# Autodesk Inventor assembly: Assembly1_stp
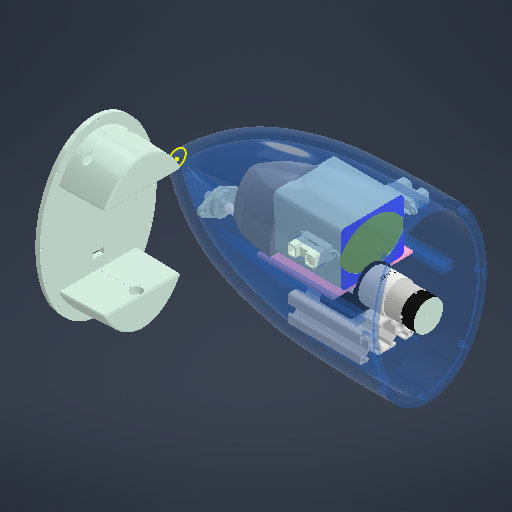
[picture p0: Inventor's stored thumbnail of the model, 512x512]
Saved by Autodesk Inventor 2027 (Build 310192060, 192F)
## iProperties
Created: 2026-07-18
Part Number: Assembly1_stp
Document SubType Name: Assembly
Designer: thita
Sending System: SIEMENS PLM Software NX 12.0
Preprocessor: ST-DEVELOPER v16.7
Title: Assembly1_stp.stp
## Documents named in this file (14)
- D:\Year2\đồ án tốt nghịp\HEAD\Workgroups\NotInProject\Assembly1_stp.iam
- D:\Year2\đồ án tốt nghịp\HEAD\Workgroups\NotInProject\DAU.ipt
- D:\Year2\đồ án tốt nghịp\HEAD\Workgroups\NotInProject\GP2Y0A02YK0F SHARP.ipt
- D:\Year2\đồ án tốt nghịp\HEAD\Workgroups\NotInProject\Khối pin sạc Li-ion 12V 21Ah 30A 3S MTM.ipt
- D:\Year2\đồ án tốt nghịp\HEAD\Workgroups\NotInProject\NAP.ipt
- D:\Year2\đồ án tốt nghịp\HEAD\Workgroups\NotInProject\5mm to 8mm rigid shaft coupler v2.ipt
- D:\Year2\đồ án tốt nghịp\HEAD\Workgroups\NotInProject\vitme-t8-buoc2.ipt
- D:\Year2\đồ án tốt nghịp\HEAD\Workgroups\NotInProject\JGB37-520.ipt
- D:\Year2\đồ án tốt nghịp\HEAD\Workgroups\NotInProject\Document.ipt
- D:\Year2\đồ án tốt nghịp\HEAD\Workgroups\NotInProject\MIENG SAT DE DO.ipt
- D:\Year2\đồ án tốt nghịp\HEAD\Workgroups\NotInProject\Ta bang inox.ipt
- D:\Year2\đồ án tốt nghịp\HEAD\Workgroups\NotInProject\nut housing T8.ipt
- D:\Year2\đồ án tốt nghịp\HEAD\Workgroups\NotInProject\JGB37-520 12 v metal geared motor bracket.ipt
- D:\Year2\đồ án tốt nghịp\HEAD\Workgroups\NotInProject\3060 Aluminum Extrusion Profile.ipt
## Components (14 placed, 14 different names)
1. DAU_1001
2. GP2Y0A02YK0F SHARP_1002
3. GP2Y0A02YK0F SHARP_1003
4. Khối pin sạc Li-ion 12V 21Ah 30A 3S MTM_1004 — Rigid:3
5. NAP_1005
6. 5mm to 8mm rigid shaft coupler v2_1008
7. vitme-t8-buoc2_1009 — Mate:1, Mate:2
8. JGB37-520_1010 — Mate:3, Mate:4
9. Document_1011
10. MIENG SAT DE DO_1012 — Rigid:1, Rigid:2, Rigid:3
11. Ta bang inox_1013 — Rigid:2
12. nut housing T8_1014 — Mate:1, Mate:2, Rigid:1
13. JGB37-520 12 v metal geared motor bracket:2 — Mate:3, Mate:4, Rigid:4
14. 3060 Aluminum Extrusion Profile:1 — Rigid:4
## Relationships (8: Mate 4, WeldJoint 4)
- Mate:1: vitme-t8-buoc2_1009 ↔ nut housing T8_1014
- Mate:2: vitme-t8-buoc2_1009 ↔ nut housing T8_1014
- Rigid:1 [WeldJoint]: MIENG SAT DE DO_1012 ↔ nut housing T8_1014
- Rigid:2 [WeldJoint]: MIENG SAT DE DO_1012 ↔ Ta bang inox_1013
- Rigid:3 [WeldJoint]: Khối pin sạc Li-ion 12V 21Ah 30A 3S MTM_1004 ↔ MIENG SAT DE DO_1012
- Mate:3: JGB37-520_1010 ↔ JGB37-520 12 v metal geared motor bracket:2
- Mate:4: JGB37-520_1010 ↔ JGB37-520 12 v metal geared motor bracket:2
- Rigid:4 [WeldJoint]: JGB37-520 12 v metal geared motor bracket:2 ↔ 3060 Aluminum Extrusion Profile:1
